# Autodesk Inventor assembly: MM0937AN100_G13_003
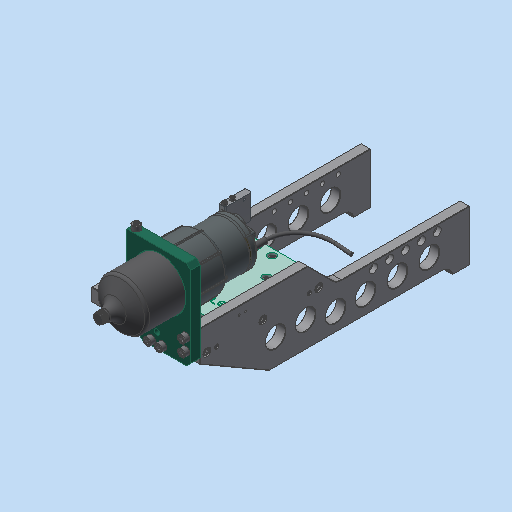
[picture p0: Inventor's stored thumbnail of the model, 512x512]
Saved by Autodesk Inventor 2023.3 (Build 273359000, 359)
## iProperties
RuleStatus: InUse
Created: 2020-12-04
Part Number: MM0937AN100_G13_003
Description: =<RBPARTNOTITLE2>
Document SubType Name: Assembly
Designer: RUD
Mass: 8097.95 g
Surface Area: 2297.88 cm^2
Volume: 1147.54 cm^3
Density: 7.05681 g/cm^3
AnP_Material: =<Material>
AnP_TemplVers: 20200821
RBDOCUMENTTYPE: DRF
RBDOCUMENTVERSION: 00
RBDRAWINGMAINSCALE: 1:1
RBDRAWINGMISSINGSPEC: --
RBDRAWINGVOLUME: --
RBDSV1: 0850
RBGBEDGESIN1: +0,5
RBGBEDGESIN2: +0,2
RBGBEDGESOUT1: -0,3
RBGBEDGESOUT2: -0,1
RBMATERIAL: =<Material>
RBMATMEETS: --
RBMATNO: =<Part Number>
RBPARTMADEOF: --
RBPARTNO: SIEHE MNR
RBPARTNOTITLE1: --
RBPARTSAFETYINDICATOR: --
RBSURFACE: --
RBSURFACE2: --
RBZEDGESNORM: ISO13715:2002-06
RBZGENDIMCLASS: m
RBZGENDIMNORM: ISO 2768-1:1989-11
RBZGENGEOCLASS: H
RBZGENGEONORM: ISO 2768-2:1989-11
RBZSURFACENORM: ISO13D2:2002-02
RBZTOLERANCENORM: ISO 14405-1:2010-12
Author: RUD
Keywords: =<RBPARTMADEOF>
Comments: =<RBSURFACE2>
Revision Number: 01
## Documents named in this file (15)
- C:\Users\rea9an\Documents\Inventor\TCAI2412_te1910_EM\AS00000906.iam
- C:\Users\rea9an\Documents\Inventor\TCAI2412_te1910_EM\PT00004502.ipt
- C:\Users\rea9an\Documents\Inventor\TCAI2412_te1910_EM\PT00004877.ipt
- C:\Users\rea9an\Documents\Inventor\TCAI2412_te1910_EM\PT00004501.ipt
- C:\Users\rea9an\Documents\Inventor\TCAI2412_te1910_EM\PT00004878.ipt
- C:\Users\rea9an\Documents\Inventor\TCAI2412_te1910_EM\PT00004497.ipt
- C:\Users\rea9an\Documents\Inventor\TCAI2412_te1910_EM\PT00004862.ipt
- C:\Users\rea9an\Documents\Inventor\TCAI2412_te1910_EM\PT00004923.ipt
- C:\Users\rea9an\Documents\Inventor\TCAI2412_te1910_EM\PT00004505.ipt
- C:\Users\rea9an\Documents\Inventor\TCAI2412_te1910_EM\PT00004499.ipt
- C:\Users\rea9an\Documents\Inventor\TCAI2412_te1910_EM\PT00004888.ipt
- C:\Users\rea9an\Documents\Inventor\TCAI2412_te1910_EM\PT00004892.ipt
- C:\Users\rea9an\Documents\Inventor\TCAI2412_te1910_EM\PT00004542.ipt
- C:\Users\rea9an\Documents\Inventor\TCAI2412_te1910_EM\PT00004543.ipt
- C:\Users\rea9an\Documents\Inventor\TCAI2412_te1910_EM\PT00004544.ipt
## Components (41 placed, 14 different names)
1. PT00004542:1 — Passend:1, Passend:2, Passend:3, Passend:4, Passend:5, Passend:6, Passend:7, Passend:8, Winkel:1, Passend:9, Einfügen:1, Einfügen:2, Einfügen:3, Einfügen:4, Einfügen:5, Einfügen:6, Einfügen:7, Einfügen:8, Einfügen:9, Einfügen:10, Einfügen:11, Einfügen:12, Einfügen:25, Einfügen:26, Einfügen:31, Einfügen:32, Fluchtend:13, Einfügen:37
2. PT00004543:1 — Einfügen:11, Einfügen:12, Einfügen:18, Einfügen:19, Einfügen:20
3. PT00004544:1 — Einfügen:31, Einfügen:32, Einfügen:33, Einfügen:34, Einfügen:35, Einfügen:36
4. PT00004497:1 — Einfügen:25, Einfügen:26, Einfügen:27, Einfügen:28
5. PT00004499:1 — Einfügen:36, Einfügen:37, Passend:10, Einfügen:38, Einfügen:39, Einfügen:40, Einfügen:41, Einfügen:42
6. PT00004501:1 — Einfügen:10
7. PT00004501:2 — Einfügen:9
8. PT00004502:1 — Passend:2, Winkel:1, Winkel:2, Fluchtend:2, Fluchtend:3
9. PT00004502:2 — Passend:1, Winkel:3, Winkel:4, Passend:9, Fluchtend:1
10. PT00004502:3 — Passend:3, Winkel:4, Winkel:5, Fluchtend:1, Fluchtend:2
11. PT00004502:4 — Passend:4, Winkel:2, Winkel:3, Fluchtend:3, Fluchtend:4
12. PT00004502:5 — Passend:5, Winkel:5, Winkel:6, Fluchtend:7
13. PT00004502:6 — Passend:6, Winkel:8, Fluchtend:4, Fluchtend:5
14. PT00004502:7 — Passend:7, Winkel:6, Winkel:7, Fluchtend:6, Fluchtend:7
15. PT00004502:8 — Passend:8, Winkel:7, Winkel:8, Fluchtend:5, Fluchtend:6
16. PT00004505:2 — Fluchtend:13, Passend:10
17. PT00004862:1 — Einfügen:28
18. PT00004862:2 — Einfügen:27
19. PT00004877:1 — Einfügen:1
20. PT00004877:2 — Einfügen:2
21. PT00004877:3 — Einfügen:3
22. PT00004877:4 — Einfügen:4
23. PT00004877:5 — Einfügen:5
24. PT00004877:6 — Einfügen:6
25. PT00004877:7 — Einfügen:7
26. PT00004877:8 — Einfügen:8
27. PT00004878:1 — Einfügen:18
28. PT00004878:2 — Einfügen:19
29. PT00004878:3 — Einfügen:20
30. PT00004878:4 — Einfügen:33
31. PT00004878:5 — Einfügen:34
32. PT00004878:6 — Einfügen:35
33. PT00004888:1 — Einfügen:39
34. PT00004888:2 — Einfügen:40
35. PT00004888:3 — Einfügen:41
36. PT00004888:4 — Einfügen:42
37. PT00004892:1 — Einfügen:38
38. PT00004923:1
39. PT00004923:2
40. PT00004923:3
41. PT00004923:4
## Relationships (61: Insert 35, Mate 10, Angle 8, Flush 8)
- Passend:1 [Mate]: PT00004542:1 ↔ PT00004502:2
- Passend:2 [Mate]: PT00004542:1 ↔ PT00004502:1
- Passend:3 [Mate]: PT00004542:1 ↔ PT00004502:3
- Passend:4 [Mate]: PT00004542:1 ↔ PT00004502:4
- Passend:5 [Mate]: PT00004542:1 ↔ PT00004502:5
- Passend:6 [Mate]: PT00004542:1 ↔ PT00004502:6
- Passend:7 [Mate]: PT00004542:1 ↔ PT00004502:7
- Passend:8 [Mate]: PT00004542:1 ↔ PT00004502:8
- Winkel:1 [Angle] (0 deg): PT00004542:1 ↔ PT00004502:1
- Winkel:2 [Angle] (0 deg): PT00004502:1 ↔ PT00004502:4
- Winkel:3 [Angle] (0 deg): PT00004502:2 ↔ PT00004502:4
- Winkel:4 [Angle] (0 deg): PT00004502:2 ↔ PT00004502:3
- Winkel:5 [Angle] (0 deg): PT00004502:3 ↔ PT00004502:5
- Winkel:6 [Angle] (0 deg): PT00004502:5 ↔ PT00004502:7
- Winkel:7 [Angle] (0 deg): PT00004502:7 ↔ PT00004502:8
- Winkel:8 [Angle] (0 deg): PT00004502:6 ↔ PT00004502:8
- Passend:9 [Mate] (3.5 mm): PT00004542:1 ↔ PT00004502:2
- Fluchtend:1 [Flush]: PT00004502:2 ↔ PT00004502:3
- Fluchtend:2 [Flush]: PT00004502:1 ↔ PT00004502:3
- Fluchtend:3 [Flush]: PT00004502:1 ↔ PT00004502:4
- Fluchtend:4 [Flush]: PT00004502:4 ↔ PT00004502:6
- Fluchtend:5 [Flush]: PT00004502:6 ↔ PT00004502:8
- Fluchtend:6 [Flush]: PT00004502:7 ↔ PT00004502:8
- Fluchtend:7 [Flush]: PT00004502:5 ↔ PT00004502:7
- Einfügen:1 [Insert]: PT00004542:1 ↔ PT00004877:1
- Einfügen:2 [Insert]: PT00004542:1 ↔ PT00004877:2
- Einfügen:3 [Insert]: PT00004542:1 ↔ PT00004877:3
- Einfügen:4 [Insert]: PT00004542:1 ↔ PT00004877:4
- Einfügen:5 [Insert]: PT00004542:1 ↔ PT00004877:5
- Einfügen:6 [Insert]: PT00004542:1 ↔ PT00004877:6
- Einfügen:7 [Insert]: PT00004542:1 ↔ PT00004877:7
- Einfügen:8 [Insert]: PT00004542:1 ↔ PT00004877:8
- Einfügen:9 [Insert]: PT00004542:1 ↔ PT00004501:2
- Einfügen:10 [Insert]: PT00004542:1 ↔ PT00004501:1
- Einfügen:11 [Insert]: PT00004542:1 ↔ PT00004543:1
- Einfügen:12 [Insert]: PT00004542:1 ↔ PT00004543:1
- Einfügen:18 [Insert]: PT00004543:1 ↔ PT00004878:1
- Einfügen:19 [Insert]: PT00004543:1 ↔ PT00004878:2
- Einfügen:20 [Insert]: PT00004543:1 ↔ PT00004878:3
- [Insert]: PT00004543:1 ↔ PT00004923:1
- [Insert]: PT00004543:1 ↔ PT00004923:2
- Einfügen:25 [Insert]: PT00004542:1 ↔ PT00004497:1
- Einfügen:26 [Insert]: PT00004542:1 ↔ PT00004497:1
- Einfügen:27 [Insert]: PT00004497:1 ↔ PT00004862:2
- Einfügen:28 [Insert]: PT00004497:1 ↔ PT00004862:1
- [Insert]: PT00004544:1 ↔ PT00004923:3
- [Insert]: PT00004544:1 ↔ PT00004923:4
- Einfügen:31 [Insert]: PT00004542:1 ↔ PT00004544:1
- Einfügen:32 [Insert]: PT00004542:1 ↔ PT00004544:1
- Einfügen:33 [Insert]: PT00004544:1 ↔ PT00004878:4
- Einfügen:34 [Insert]: PT00004544:1 ↔ PT00004878:5
- Einfügen:35 [Insert]: PT00004544:1 ↔ PT00004878:6
- Fluchtend:13 [Flush] (90 mm): PT00004542:1 ↔ PT00004505:2
- Einfügen:36 [Insert]: PT00004544:1 ↔ PT00004499:1
- Einfügen:37 [Insert]: PT00004542:1 ↔ PT00004499:1
- Passend:10 [Mate]: PT00004499:1 ↔ PT00004505:2
- Einfügen:38 [Insert]: PT00004499:1 ↔ PT00004892:1
- Einfügen:39 [Insert]: PT00004499:1 ↔ PT00004888:1
- Einfügen:40 [Insert]: PT00004499:1 ↔ PT00004888:2
- Einfügen:41 [Insert]: PT00004499:1 ↔ PT00004888:3
- Einfügen:42 [Insert]: PT00004499:1 ↔ PT00004888:4
